# Autodesk Inventor assembly: transit-whole
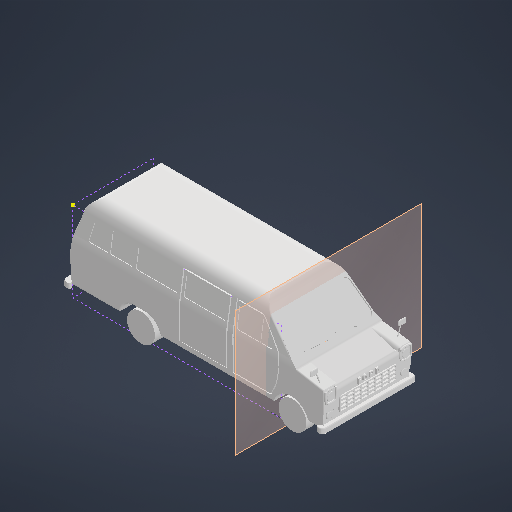
[picture p0: Inventor's stored thumbnail of the model, 512x512]
Saved by Autodesk Inventor 2027.2 (Build 312334000, 334)
## iProperties
Created: 2026-11-20
Part Number: transit-whole
Document SubType Name: Assembly
Designer: dodo
Author: dodo
## Documents named in this file (6)
- C:\Users\dodo\Desktop\studia\Transit-Mk1-3D\final-scale-1-25\transit-whole.iam
- C:\Users\dodo\Desktop\studia\Transit-Mk1-3D\final-scale-1-25\body.ipt
- C:\Users\dodo\Desktop\studia\Transit-Mk1-3D\final-scale-1-25\wheel_on_axle.ipt
- C:\Users\dodo\Desktop\studia\Transit-Mk1-3D\final-scale-1-25\wheel.ipt
- C:\Users\dodo\Desktop\studia\Transit-Mk1-3D\final-scale-1-25\wheel_on_axle_twin.ipt
- C:\Users\dodo\Desktop\studia\Transit-Mk1-3D\final-scale-1-25\wheel_for_twin.ipt
## Components (6 placed, 5 different names)
1. body:1 — Insert:1, Insert:3
2. wheel_on_axle:1 — Insert:1, Insert:2
3. wheel:1 — Insert:2
4. wheel_on_axle_twin:1 — Insert:3, Insert:4, Insert:5
5. wheel_for_twin:1 — Insert:4
6. wheel:2 — Insert:5
## Relationships (5: Insert 5)
- Insert:1 (-6 mm): body:1 ↔ wheel_on_axle:1
- Insert:2: wheel_on_axle:1 ↔ wheel:1
- Insert:3 (-11 mm): body:1 ↔ wheel_on_axle_twin:1
- Insert:4 (-4.5 mm): wheel_on_axle_twin:1 ↔ wheel_for_twin:1
- Insert:5: wheel_on_axle_twin:1 ↔ wheel:2
